# Autodesk Inventor assembly: DRONE
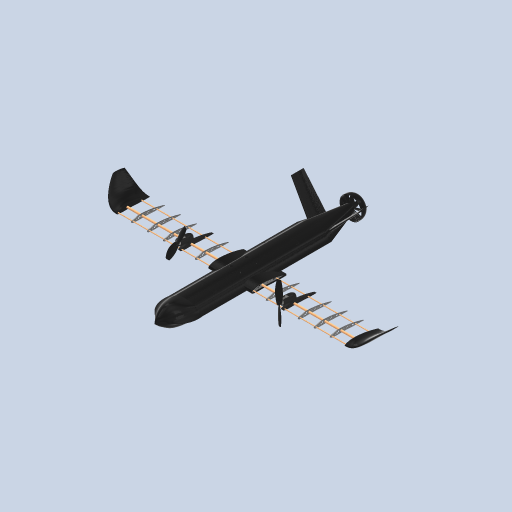
[picture p0: Inventor's stored thumbnail of the model, 512x512]
Saved by Autodesk Inventor 2023 (Build 270158000, 158)
## iProperties
Created: 2023-06-16
Part Number: DRONE
Document SubType Name: Assembly
Designer: brand
Author: brand
## Documents named in this file (18)
- C:\Users\brand\Desktop\PROJECTS\DRONE_DESIGN\PARTS\DRONE.iam
- C:\Users\brand\Desktop\PROJECTS\DRONE_DESIGN\PARTS\ENCASTRE_FUSELAJE_inferior.ipt
- C:\Users\brand\Desktop\PROJECTS\DRONE_DESIGN\PARTS\varilla 8mm.ipt
- C:\Users\brand\Desktop\PROJECTS\DRONE_DESIGN\PARTS\varilla 4mm.ipt
- C:\Users\brand\Desktop\PROJECTS\DRONE_DESIGN\PARTS\ENCASTRE_FUSELAJE_superior.ipt
- C:\Users\brand\Desktop\PROJECTS\DRONE_DESIGN\PARTS\COLA_v2.ipt
- C:\Users\brand\Desktop\PROJECTS\DRONE_DESIGN\PARTS\WNGTIP_DERECHO.ipt
- C:\Users\brand\Desktop\PROJECTS\DRONE_DESIGN\PARTS\WNGTIP_IZQUIERDO.ipt
- C:\Users\brand\Desktop\PROJECTS\DRONE_DESIGN\PARTS\COSTILLA_CENTRAL.ipt
- C:\Users\brand\Desktop\PROJECTS\DRONE_DESIGN\PARTS\COSTILLA_MOTOR.ipt
- C:\Users\brand\Desktop\PROJECTS\DRONE_DESIGN\PARTS\COSTILLA_GENÉRICA.ipt
- C:\Users\brand\Desktop\PROJECTS\DRONE_DESIGN\PARTS\Motor_ALA.ipt
- C:\Users\brand\Desktop\PROJECTS\DRONE_DESIGN\PARTS\MOTOR_TRASERO.ipt
- C:\Users\brand\Desktop\PROJECTS\DRONE_DESIGN\PARTS\Rotor_MOTORES_ALA.ipt
- C:\Users\brand\Desktop\PROJECTS\DRONE_DESIGN\PARTS\MORRO.ipt
- C:\Users\brand\Desktop\PROJECTS\DRONE_DESIGN\PARTS\HELICES\HELICE_BRANDO.ipt
- C:\Users\brand\Desktop\PROJECTS\DRONE_DESIGN\PARTS\HELICES\HELICE_BRANDO_INVERSA.ipt
- C:\Users\brand\Desktop\PROJECTS\DRONE_DESIGN\PARTS\HELICES\HELICE_BRANDO_FAN_MITAD.ipt
## Components (30 placed, 17 different names)
1. ENCASTRE_FUSELAJE_inferior:1 — Coincidencia:1, Coincidencia:2, Coincidencia:3, Coincidencia:10, Coincidencia:11, Coincidencia:12, Coincidencia:13, Coincidencia:14, Coincidencia:16, Coincidencia:45, Coincidencia:59, Coincidencia:60
2. varilla 8mm:1 — Coincidencia:2, Nivelación:1, Nivelación:2, Coincidencia:4, Coincidencia:5, Coincidencia:7, Coincidencia:8, De rotación:1, Coincidencia:17, Coincidencia:18, Coincidencia:19, Coincidencia:21, Coincidencia:23, Coincidencia:25, Coincidencia:27, Coincidencia:29, Coincidencia:31, Coincidencia:33, Coincidencia:66, Coincidencia:68
3. varilla 4mm:1 — Coincidencia:1, Nivelación:1
4. varilla 4mm:2 — Coincidencia:3, Nivelación:2, Coincidencia:6, Coincidencia:9, Coincidencia:15, Coincidencia:20, Coincidencia:22, Coincidencia:24, Coincidencia:26, Coincidencia:28, Coincidencia:30, Coincidencia:32, Coincidencia:34, Coincidencia:67, Coincidencia:69
5. ENCASTRE_FUSELAJE_superior:1 — Coincidencia:10, Coincidencia:11, Coincidencia:45, Coincidencia:76
6. COLA_v2:1 — Coincidencia:12, Coincidencia:13, Coincidencia:14, Nivelación:5, Coincidencia:50
7. WNGTIP_DERECHO:1 — Coincidencia:7, Coincidencia:8, Coincidencia:9, Ángulo:1, Ángulo:2, Coincidencia:73
8. WNGTIP_IZQUIERDO:1 — Coincidencia:4, Coincidencia:5, Coincidencia:6, Coincidencia:74
9. COSTILLA_CENTRAL:1 — De rotación:1, Coincidencia:15, Coincidencia:16
10. COSTILLA_MOTOR:1 — Ángulo:1, Coincidencia:17, Coincidencia:37, Coincidencia:38, Coincidencia:46, Coincidencia:47, Nivelación:3
11. COSTILLA_MOTOR:2 — Ángulo:2, Coincidencia:18, Coincidencia:42, Coincidencia:43, Coincidencia:48, Nivelación:4, Coincidencia:49
12. COSTILLA_GENÉRICA:1 — Coincidencia:19, Coincidencia:20, Coincidencia:36, Coincidencia:72
13. COSTILLA_GENÉRICA:2 — Coincidencia:21, Coincidencia:22, Coincidencia:38, Coincidencia:39
14. COSTILLA_GENÉRICA:3 — Coincidencia:23, Coincidencia:24, Coincidencia:39
15. COSTILLA_GENÉRICA:4 — Coincidencia:25, Coincidencia:26, Coincidencia:36, Coincidencia:37
16. COSTILLA_GENÉRICA:5 — Coincidencia:29, Coincidencia:30, Coincidencia:41, Coincidencia:75
17. COSTILLA_GENÉRICA:6 — Coincidencia:31, Coincidencia:32, Coincidencia:43, Coincidencia:44
18. COSTILLA_GENÉRICA:7 — Coincidencia:33, Coincidencia:34, Coincidencia:44
19. COSTILLA_GENÉRICA:8 — Coincidencia:27, Coincidencia:28, Coincidencia:41, Coincidencia:42
20. Motor_ALA:1 — Coincidencia:48, Nivelación:4, Coincidencia:49, Coincidencia:52, Nivelación:7, Coincidencia:63
21. Motor_ALA:2 — Coincidencia:46, Coincidencia:47, Nivelación:3, Coincidencia:51, Nivelación:6, Coincidencia:65
22. MOTOR_TRASERO:1 — Nivelación:5, Coincidencia:50, Coincidencia:70, Coincidencia:71
23. Rotor_MOTORES_ALA:1 — Coincidencia:51, Nivelación:6, Coincidencia:64
24. Rotor_MOTORES_ALA:2 — Coincidencia:52, Nivelación:7, Coincidencia:62
25. MORRO:1 — Coincidencia:59, Coincidencia:60, Coincidencia:76
26. HELICE_BRANDO:1 — Coincidencia:62, Coincidencia:63
27. HELICE_BRANDO_INVERSA:1 — Coincidencia:64, Coincidencia:65
28. COSTILLA_GENÉRICA:9 — Coincidencia:66, Coincidencia:67, Coincidencia:72, Coincidencia:73
29. COSTILLA_GENÉRICA:10 — Coincidencia:68, Coincidencia:69, Coincidencia:74, Coincidencia:75
30. HELICE_BRANDO_FAN_MITAD:1 — Coincidencia:70, Coincidencia:71, Ángulo:3
## Relationships (78: Mate 67, Flush 7, Angle 3, RevoluteJoint 1)
- Coincidencia:1 [Mate]: ENCASTRE_FUSELAJE_inferior:1 ↔ varilla 4mm:1
- Coincidencia:2 [Mate]: ENCASTRE_FUSELAJE_inferior:1 ↔ varilla 8mm:1
- Coincidencia:3 [Mate]: ENCASTRE_FUSELAJE_inferior:1 ↔ varilla 4mm:2
- Nivelación:1 [Flush]: varilla 8mm:1 ↔ varilla 4mm:1
- Nivelación:2 [Flush]: varilla 8mm:1 ↔ varilla 4mm:2
- Coincidencia:4 [Mate]: varilla 8mm:1 ↔ WNGTIP_IZQUIERDO:1
- Coincidencia:5 [Mate]: varilla 8mm:1 ↔ WNGTIP_IZQUIERDO:1
- Coincidencia:6 [Mate]: varilla 4mm:2 ↔ WNGTIP_IZQUIERDO:1
- Coincidencia:7 [Mate]: varilla 8mm:1 ↔ WNGTIP_DERECHO:1
- Coincidencia:8 [Mate]: varilla 8mm:1 ↔ WNGTIP_DERECHO:1
- Coincidencia:9 [Mate]: varilla 4mm:2 ↔ WNGTIP_DERECHO:1
- Coincidencia:10 [Mate]: ENCASTRE_FUSELAJE_inferior:1 ↔ ENCASTRE_FUSELAJE_superior:1
- Coincidencia:11 [Mate]: ENCASTRE_FUSELAJE_inferior:1 ↔ ENCASTRE_FUSELAJE_superior:1
- Coincidencia:12 [Mate]: ENCASTRE_FUSELAJE_inferior:1 ↔ COLA_v2:1
- Coincidencia:13 [Mate]: ENCASTRE_FUSELAJE_inferior:1 ↔ COLA_v2:1
- Coincidencia:14 [Mate]: ENCASTRE_FUSELAJE_inferior:1 ↔ COLA_v2:1
- De rotación:1 [RevoluteJoint]: varilla 8mm:1 ↔ COSTILLA_CENTRAL:1
- Coincidencia:15 [Mate]: varilla 4mm:2 ↔ COSTILLA_CENTRAL:1
- Coincidencia:16 [Mate]: ENCASTRE_FUSELAJE_inferior:1 ↔ COSTILLA_CENTRAL:1
- Ángulo:1 [Angle] (0 deg): WNGTIP_DERECHO:1 ↔ COSTILLA_MOTOR:1
- Coincidencia:17 [Mate]: varilla 8mm:1 ↔ COSTILLA_MOTOR:1
- Ángulo:2 [Angle] (0 deg): WNGTIP_DERECHO:1 ↔ COSTILLA_MOTOR:2
- Coincidencia:18 [Mate]: varilla 8mm:1 ↔ COSTILLA_MOTOR:2
- Coincidencia:19 [Mate]: varilla 8mm:1 ↔ COSTILLA_GENÉRICA:1
- Coincidencia:20 [Mate]: varilla 4mm:2 ↔ COSTILLA_GENÉRICA:1
- Coincidencia:21 [Mate]: varilla 8mm:1 ↔ COSTILLA_GENÉRICA:2
- Coincidencia:22 [Mate]: varilla 4mm:2 ↔ COSTILLA_GENÉRICA:2
- Coincidencia:23 [Mate]: varilla 8mm:1 ↔ COSTILLA_GENÉRICA:3
- Coincidencia:24 [Mate]: varilla 4mm:2 ↔ COSTILLA_GENÉRICA:3
- Coincidencia:25 [Mate]: varilla 8mm:1 ↔ COSTILLA_GENÉRICA:4
- Coincidencia:26 [Mate]: varilla 4mm:2 ↔ COSTILLA_GENÉRICA:4
- Coincidencia:27 [Mate]: varilla 8mm:1 ↔ COSTILLA_GENÉRICA:8
- Coincidencia:28 [Mate]: varilla 4mm:2 ↔ COSTILLA_GENÉRICA:8
- Coincidencia:29 [Mate]: varilla 8mm:1 ↔ COSTILLA_GENÉRICA:5
- Coincidencia:30 [Mate]: varilla 4mm:2 ↔ COSTILLA_GENÉRICA:5
- Coincidencia:31 [Mate]: varilla 8mm:1 ↔ COSTILLA_GENÉRICA:6
- Coincidencia:32 [Mate]: varilla 4mm:2 ↔ COSTILLA_GENÉRICA:6
- Coincidencia:33 [Mate]: varilla 8mm:1 ↔ COSTILLA_GENÉRICA:7
- Coincidencia:34 [Mate]: varilla 4mm:2 ↔ COSTILLA_GENÉRICA:7
- Coincidencia:36 [Mate] (64 mm): COSTILLA_GENÉRICA:1 ↔ COSTILLA_GENÉRICA:4
- Coincidencia:37 [Mate] (61 mm): COSTILLA_MOTOR:1 ↔ COSTILLA_GENÉRICA:4
- Coincidencia:38 [Mate] (61 mm): COSTILLA_MOTOR:1 ↔ COSTILLA_GENÉRICA:2
- Coincidencia:39 [Mate] (60 mm): COSTILLA_GENÉRICA:2 ↔ COSTILLA_GENÉRICA:3
- Coincidencia:41 [Mate] (64 mm): COSTILLA_GENÉRICA:5 ↔ COSTILLA_GENÉRICA:8
- Coincidencia:42 [Mate] (61 mm): COSTILLA_MOTOR:2 ↔ COSTILLA_GENÉRICA:8
- Coincidencia:43 [Mate] (61 mm): COSTILLA_MOTOR:2 ↔ COSTILLA_GENÉRICA:6
- Coincidencia:44 [Mate] (60 mm): COSTILLA_GENÉRICA:6 ↔ COSTILLA_GENÉRICA:7
- Coincidencia:45 [Mate]: ENCASTRE_FUSELAJE_inferior:1 ↔ ENCASTRE_FUSELAJE_superior:1
- Coincidencia:46 [Mate]: COSTILLA_MOTOR:1 ↔ Motor_ALA:2
- Coincidencia:47 [Mate]: COSTILLA_MOTOR:1 ↔ Motor_ALA:2
- Nivelación:3 [Flush]: COSTILLA_MOTOR:1 ↔ Motor_ALA:2
- Coincidencia:48 [Mate]: COSTILLA_MOTOR:2 ↔ Motor_ALA:1
- Nivelación:4 [Flush]: COSTILLA_MOTOR:2 ↔ Motor_ALA:1
- Coincidencia:49 [Mate]: COSTILLA_MOTOR:2 ↔ Motor_ALA:1
- Nivelación:5 [Flush]: COLA_v2:1 ↔ MOTOR_TRASERO:1
- Coincidencia:50 [Mate]: COLA_v2:1 ↔ MOTOR_TRASERO:1
- Coincidencia:51 [Mate]: Motor_ALA:2 ↔ Rotor_MOTORES_ALA:1
- Nivelación:6 [Flush] (-5 mm): Motor_ALA:2 ↔ Rotor_MOTORES_ALA:1
- Coincidencia:52 [Mate]: Motor_ALA:1 ↔ Rotor_MOTORES_ALA:2
- Nivelación:7 [Flush] (-5 mm): Motor_ALA:1 ↔ Rotor_MOTORES_ALA:2
- Coincidencia:59 [Mate]: ENCASTRE_FUSELAJE_inferior:1 ↔ MORRO:1
- Coincidencia:60 [Mate]: ENCASTRE_FUSELAJE_inferior:1 ↔ MORRO:1
- Coincidencia:62 [Mate]: Rotor_MOTORES_ALA:2 ↔ HELICE_BRANDO:1
- Coincidencia:63 [Mate]: Motor_ALA:1 ↔ HELICE_BRANDO:1
- Coincidencia:64 [Mate]: Rotor_MOTORES_ALA:1 ↔ HELICE_BRANDO_INVERSA:1
- Coincidencia:65 [Mate]: Motor_ALA:2 ↔ HELICE_BRANDO_INVERSA:1
- Coincidencia:66 [Mate]: varilla 8mm:1 ↔ COSTILLA_GENÉRICA:9
- Coincidencia:67 [Mate]: varilla 4mm:2 ↔ COSTILLA_GENÉRICA:9
- Coincidencia:68 [Mate]: varilla 8mm:1 ↔ COSTILLA_GENÉRICA:10
- Coincidencia:69 [Mate]: varilla 4mm:2 ↔ COSTILLA_GENÉRICA:10
- Coincidencia:70 [Mate]: MOTOR_TRASERO:1 ↔ HELICE_BRANDO_FAN_MITAD:1
- Coincidencia:71 [Mate]: MOTOR_TRASERO:1 ↔ HELICE_BRANDO_FAN_MITAD:1
- Ángulo:3 [Angle] (0 deg): HELICE_BRANDO_FAN_MITAD:1
- Coincidencia:72 [Mate] (64 mm): COSTILLA_GENÉRICA:1 ↔ COSTILLA_GENÉRICA:9
- Coincidencia:73 [Mate] (60 mm): WNGTIP_DERECHO:1 ↔ COSTILLA_GENÉRICA:9
- Coincidencia:74 [Mate] (60 mm): WNGTIP_IZQUIERDO:1 ↔ COSTILLA_GENÉRICA:10
- Coincidencia:75 [Mate] (64 mm): COSTILLA_GENÉRICA:5 ↔ COSTILLA_GENÉRICA:10
- Coincidencia:76 [Mate]: ENCASTRE_FUSELAJE_superior:1 ↔ MORRO:1
